# Autodesk Inventor assembly: senior base design v1
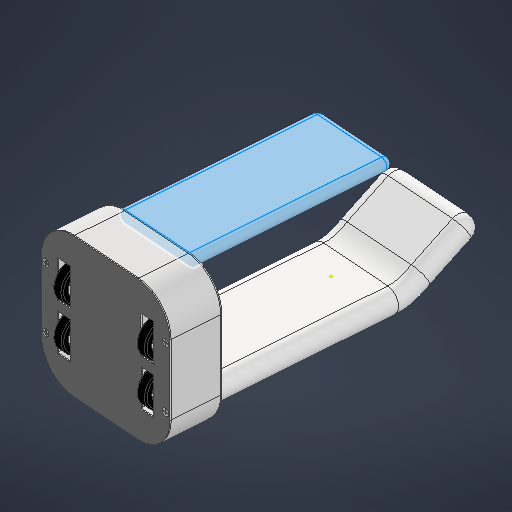
[picture p0: Inventor's stored thumbnail of the model, 512x512]
Saved by Autodesk Inventor 2025.2 (Build 292293000, 293)
## iProperties
Created: 2024-12-25
Part Number: senior base design v1
Document SubType Name: Assembly
Designer: user
Author: user
## Documents named in this file (18)
- C:\Users\user\OneDrive\Senior\senior base design v1.iam
- C:\Users\user\OneDrive\Senior\motor 1.ipt
- C:\Users\user\OneDrive\Senior\plate.ipt
- C:\Users\user\OneDrive\Senior\wheel.ipt
- C:\Users\user\OneDrive\Senior\wheel support.ipt
- C:\Users\user\OneDrive\Senior\wheel support_MIR1.ipt
- C:\Users\user\OneDrive\Senior\wheel_MIR.ipt
- C:\Users\user\OneDrive\Senior\washer.ipt
- C:\Users\user\OneDrive\Senior\bolt.ipt
- C:\Users\user\OneDrive\Senior\washer_MIR.ipt
- C:\Users\user\OneDrive\Senior\bolt_MIR.ipt
- C:\Users\user\OneDrive\Senior\motor support1.ipt
- C:\Users\user\OneDrive\Senior\sides cover.ipt
- C:\Users\user\OneDrive\Senior\plate cover.ipt
- C:\Users\user\OneDrive\Senior\screw.ipt
- C:\Users\user\OneDrive\Senior\Back Pillar.ipt
- C:\Users\user\OneDrive\Senior\front pillar.ipt
- C:\Users\user\OneDrive\Senior\screen.ipt
## Components (30 placed, 17 different names)
1. motor 1:1 — Mate:1, Rotational:1, Tangent:1, Mate:13, Mate:14, Mate:15
2. plate:1 — Mate:3, Tangent:1, Tangent:2, Mate:4, Slider:2, Angle:1, Angle:2, Mate:8, Mate:12, Mate:18, Flush:1, Mate:22, Mate:23, Flush:2, Flush:3, Mate:28, Flush:4, Flush:7, Flush:8, Flush:9, Flush:10
3. wheel:1 — Mate:1, Rotational:1, Mate:3, Mate:19
4. motor 1:2 — Tangent:2, Mate:16, Mate:17
5. wheel:2 — Mate:4, Mate:19
6. wheel support:1 — Slider:2, Mate:7, Mate:9, Flush:1, Mate:21
7. wheel support:4 — Mate:7, Mate:8, Mate:9, Rigid:1
8. wheel:3 — Rotational:3
9. wheel support_MIR1:1 — Mate:10, Mate:11, Mate:23, Mate:24, Mate:27
10. wheel support_MIR1:2 — Mate:10, Mate:11, Mate:22, Flush:2, Mate:25
11. wheel_MIR:1 — Rotational:4
12. washer:1 — Mate:20, Mate:21
13. bolt:1 — Rigid:1, Rotational:3, Mate:20
14. washer_MIR:1 — Mate:26, Mate:27
15. bolt_MIR:1 — Mate:24, Mate:25, Rotational:4, Mate:26
16. motor support1:1 — Mate:12, Mate:13, Mate:14, Mate:15
17. motor support1:2 — Mate:16, Mate:17, Mate:18
18. sides cover:1 — Flush:3, Mate:28, Flush:4, Mate:32, Mate:33, Flush:5, Flush:6, Mate:34, Mate:35, Mate:36, Mate:37, Mate:38, Mate:39, Mate:40, Mate:41, Flush:15
19. plate cover:1 — Mate:32, Mate:33, Flush:5, Flush:6, Flush:11, Flush:12, Flush:13, Flush:14, Mate:42, Mate:48
20. screw:1 — Mate:34, Flush:7
21. screw:2 — Mate:40, Flush:11
22. screw:3 — Mate:38, Flush:12
23. screw:4 — Mate:36, Flush:10
24. screw:5 — Mate:35, Flush:8
25. screw:6 — Mate:37, Flush:9
26. screw:7 — Mate:39, Flush:13
27. screw:8 — Mate:41, Flush:14
28. Back Pillar:1 — Mate:42, Flush:15
29. front pillar:1 — Mate:44, Mate:45, Mate:46, Mate:47, Mate:48
30. screen:1 — Mate:44, Mate:45, Mate:46, Mate:47
## Relationships (68: Mate 42, Flush 15, RevoluteJoint 4, Tangent 2, Angle 2, TranslationJoint 1, Symmetry 1, WeldJoint 1)
- Mate:1: motor 1:1 ↔ wheel:1
- Rotational:1 [RevoluteJoint]: motor 1:1 ↔ wheel:1
- [Mate]: motor 1:2 ↔ wheel:2
- [RevoluteJoint]: motor 1:2 ↔ wheel:2
- Mate:3 (7.5 mm): plate:1 ↔ wheel:1
- Tangent:1: motor 1:1 ↔ plate:1
- Tangent:2: plate:1 ↔ motor 1:2
- Mate:4 (7.5 mm): plate:1 ↔ wheel:2
- Slider:2 [TranslationJoint]: plate:1 ↔ wheel support:1
- Angle:1 (0 deg): plate:1
- Angle:2 (0 deg): plate:1
- Symmetry:1
- Mate:7: wheel support:1 ↔ wheel support:4
- Mate:8: plate:1 ↔ wheel support:4
- Mate:9 (70 mm): wheel support:1 ↔ wheel support:4
- Mate:10 (70 mm): wheel support_MIR1:1 ↔ wheel support_MIR1:2
- Mate:11: wheel support_MIR1:1 ↔ wheel support_MIR1:2
- Rigid:1 [WeldJoint]: wheel support:4 ↔ bolt:1
- Mate:12: plate:1 ↔ motor support1:1
- Mate:13: motor 1:1 ↔ motor support1:1
- Mate:14: motor 1:1 ↔ motor support1:1
- Mate:15: motor 1:1 ↔ motor support1:1
- Mate:16: motor 1:2 ↔ motor support1:2
- Mate:17: motor 1:2 ↔ motor support1:2
- Mate:18: plate:1 ↔ motor support1:2
- Mate:19: wheel:1 ↔ wheel:2
- Rotational:3 [RevoluteJoint]: wheel:3 ↔ bolt:1
- Flush:1 (-5 mm): plate:1 ↔ wheel support:1
- Mate:20: washer:1 ↔ bolt:1
- Mate:21: wheel support:1 ↔ washer:1
- Mate:22: plate:1 ↔ wheel support_MIR1:2
- Mate:23: plate:1 ↔ wheel support_MIR1:1
- Flush:2 (-5 mm): plate:1 ↔ wheel support_MIR1:2
- Mate:24: wheel support_MIR1:1 ↔ bolt_MIR:1
- Mate:25: wheel support_MIR1:2 ↔ bolt_MIR:1
- Rotational:4 [RevoluteJoint]: wheel_MIR:1 ↔ bolt_MIR:1
- Mate:26: washer_MIR:1 ↔ bolt_MIR:1
- Mate:27: wheel support_MIR1:1 ↔ washer_MIR:1
- Flush:3: plate:1 ↔ sides cover:1
- Mate:28: plate:1 ↔ sides cover:1
- Flush:4: plate:1 ↔ sides cover:1
- Mate:32: sides cover:1 ↔ plate cover:1
- Mate:33: sides cover:1 ↔ plate cover:1
- Flush:5: sides cover:1 ↔ plate cover:1
- Flush:6: sides cover:1 ↔ plate cover:1
- Mate:34: sides cover:1 ↔ screw:1
- Flush:7: plate:1 ↔ screw:1
- Mate:35: sides cover:1 ↔ screw:5
- Mate:36: sides cover:1 ↔ screw:4
- Mate:37: sides cover:1 ↔ screw:6
- Mate:38: sides cover:1 ↔ screw:3
- Mate:39: sides cover:1 ↔ screw:7
- Mate:40: sides cover:1 ↔ screw:2
- Mate:41: sides cover:1 ↔ screw:8
- Flush:8: plate:1 ↔ screw:5
- Flush:9: plate:1 ↔ screw:6
- Flush:10: plate:1 ↔ screw:4
- Flush:11: plate cover:1 ↔ screw:2
- Flush:12: plate cover:1 ↔ screw:3
- Flush:13: plate cover:1 ↔ screw:7
- Flush:14: plate cover:1 ↔ screw:8
- Mate:42: plate cover:1 ↔ Back Pillar:1
- Flush:15: sides cover:1 ↔ Back Pillar:1
- Mate:44: front pillar:1 ↔ screen:1
- Mate:45: front pillar:1 ↔ screen:1
- Mate:46: front pillar:1 ↔ screen:1
- Mate:47: front pillar:1 ↔ screen:1
- Mate:48: plate cover:1 ↔ front pillar:1
## Named parameters: d3_d0 = 0 mm, d4_d1 = 0 mm, d5_d2 = 142.928627 deg
